# Autodesk Inventor assembly: 22.10.2025 - calosc
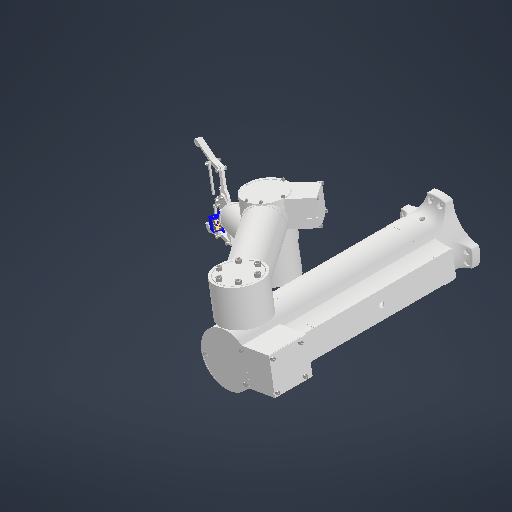
[picture p0: Inventor's stored thumbnail of the model, 512x512]
Saved by Autodesk Inventor 2026.1 (Build 301233020, 233B)
## iProperties
Created: 2026-01-25
Part Number: 22.10.2025 - calosc
Document SubType Name: Assembly
Designer: Nitro
Author: Nitro
## Documents named in this file (63)
- C:\Users\Nitro\Pictures\Bryły\22.10.2025 - calosc.iam
- C:\Users\Nitro\Pictures\Bryły\22.10.2025-01.ipt
- C:\Users\Nitro\Pictures\Bryły\22.10.2025 - calosc\Design Accelerator\Łożysko1.iam
- C:\Users\Nitro\Pictures\Bryły\22.10.2025 - calosc\Design Accelerator\Łożysko2.iam
- C:\Users\Nitro\Pictures\Bryły\22.10.2025 - calosc\Design Accelerator\Łożysko3.iam
- C:\Users\Nitro\Pictures\Bryły\22.10.2025 - calosc\Design Accelerator\Łożysko4.iam
- C:\Users\Nitro\Pictures\Bryły\22.10.2025 - calosc\Design Accelerator\Łożysko5.iam
- C:\Users\Nitro\Pictures\Bryły\22.10.2025 - calosc\Design Accelerator\Łożysko6.iam
- C:\Users\Nitro\Pictures\Bryły\22.10.2025-p2.ipt
- C:\Users\Nitro\Documents\Inventor\Content Center Files\R2026\pl-PL\CNS 3932\CNS 3932 - M 3 x 0,5 x 10.ipt
- C:\Users\Nitro\Pictures\Bryły\22.10.2025-04.ipt
- C:\Users\Nitro\Documents\Inventor\Content Center Files\R2026\pl-PL\CNS 3932\CNS 3932 - M 5 x 0,8 x 10.ipt
- C:\Users\Nitro\Documents\Inventor\Content Center Files\R2026\pl-PL\CNS 3932\CNS 3932 - M 6 x 1 x 22.ipt
- C:\Users\Nitro\Pictures\Bryły\22.10.2025-05.ipt
- C:\Users\Nitro\Documents\Inventor\Content Center Files\R2026\pl-PL\CNS 3932\CNS 3932 - M 6 x 1 x 25.ipt
- C:\Users\Nitro\Pictures\Bryły\22.10.2025-07.ipt
- C:\Users\Nitro\Documents\Inventor\Content Center Files\R2026\pl-PL\CNS 3932\CNS 3932 - M 6 x 1 x 10.ipt
- C:\Users\Nitro\Documents\Inventor\Content Center Files\R2026\pl-PL\CNS 3932\CNS 3932 - M 10 x 1,5 x 20.ipt
- C:\Users\Nitro\Pictures\Bryły\22.10.2025-12.ipt
- C:\Users\Nitro\Pictures\Bryły\22.10.2025-10.ipt
- C:\Users\Nitro\Pictures\Bryły\22.10.2025-11.ipt
- C:\Users\Nitro\Documents\Inventor\Content Center Files\R2026\pl-PL\CNS 3932\CNS 3932 - M 4 x 0,7 x 16.ipt
- C:\Users\Nitro\Pictures\Bryły\22.10.2025-p3 -p3.ipt
- C:\Users\Nitro\Pictures\Bryły\22.10.2025-p4.ipt
- C:\Users\Nitro\Pictures\Bryły\22.10.2025-s1.ipt
- C:\Users\Nitro\Pictures\Bryły\22.10.2025-08.ipt
- C:\Users\Nitro\Documents\Inventor\Content Center Files\R2026\pl-PL\CNS 3932\CNS 3932 - M 3 x 0,5 x 5.ipt
- C:\Users\Nitro\Documents\Inventor\Content Center Files\R2026\pl-PL\CNS 3932\CNS 3932 - M 4 x 0,7 x 10.ipt
- C:\Users\Nitro\Documents\Inventor\Content Center Files\R2026\pl-PL\GB 833-88\Screw GB 833 M3 x 10.ipt
- C:\Users\Nitro\Pictures\Bryły\22.10.2025-09.ipt
- C:\Users\Nitro\Documents\Inventor\Content Center Files\R2026\pl-PL\DIN 7985 (H)\DIN 7985 (H) - M3x5-H.ipt
- C:\Users\Nitro\Pictures\Bryły\22.10.2025-p1.ipt
- C:\Users\Nitro\Pictures\Bryły\22.10.2025-13.ipt
- C:\Users\Nitro\Documents\Inventor\Content Center Files\R2026\pl-PL\CNS 3932\CNS 3932 - M 8 x 1,25 x 20.ipt
- C:\Users\Nitro\Pictures\Bryły\22.10.2-25-26.ipt
- C:\Users\Nitro\Pictures\Bryły\22.10.2025-16.ipt
- C:\Users\Nitro\Pictures\Bryły\22.10.2025-25.ipt
- C:\Users\Nitro\Pictures\Bryły\22.10.2025 - calosc\Design Accelerator\Łożysko7.iam
- C:\Users\Nitro\Pictures\Bryły\22.10.2025 - calosc\Design Accelerator\Łożysko8.iam
- C:\Users\Nitro\Pictures\Bryły\22.10.2025 - calosc\Design Accelerator\Łożysko9.iam
- C:\Users\Nitro\Pictures\Bryły\22.10.2025 - calosc\Design Accelerator\Łożysko10.iam
- C:\Users\Nitro\Documents\Inventor\Content Center Files\R2026\pl-PL\CNS 3932\CNS 3932 - M 5 x 0,8 x 16.ipt
- C:\Users\Nitro\Documents\Inventor\Content Center Files\R2026\pl-PL\CNS 4355\CNS 4355 - M 3 x 30.ipt
- C:\Users\Nitro\Pictures\Bryły\22.10.2025-p6.ipt
- C:\Users\Nitro\Documents\Inventor\Content Center Files\R2026\pl-PL\CSN 02 1131  B\CSN 02 1131 - M3 x 10B.ipt
- C:\Users\Nitro\Pictures\Bryły\22.10.2025-p5.ipt
- C:\Users\Nitro\Documents\Inventor\Content Center Files\R2026\pl-PL\CSN 02 1131  B\CSN 02 1131 - M3 x 12B.ipt
- C:\Users\Nitro\Pictures\Bryły\22.10.2025-15.ipt
- C:\Users\Nitro\Pictures\Bryły\22.10.2025-14.ipt
- C:\Users\Nitro\Pictures\Bryły\22.10.2025-17.ipt
- C:\Users\Nitro\Pictures\Bryły\22.10.2025-21.ipt
- C:\Users\Nitro\Documents\Inventor\Content Center Files\R2026\pl-PL\CNS 4355\CNS 4355 - M 4 x 14.ipt
- C:\Users\Nitro\Documents\Inventor\Content Center Files\R2026\pl-PL\CNS 4355\CNS 4355 - M 4 x 10.ipt
- C:\Users\Nitro\Pictures\Bryły\22.10.2025-18.ipt
- C:\Users\Nitro\Pictures\Bryły\Część2_MIR_MIR.ipt
- C:\Users\Nitro\Pictures\Bryły\22.10.2025-20.ipt
- C:\Users\Nitro\Pictures\Bryły\22.10.2025-22.ipt
- C:\Users\Nitro\Pictures\Bryły\22.10.2025-19_MIR2_MIR.ipt
- C:\Users\Nitro\Pictures\Bryły\22.10.2025-20_MIR1.ipt
- C:\Users\Nitro\Documents\Inventor\Content Center Files\R2026\pl-PL\CNS 3932\CNS 3932 - M 4 x 0,7 x 14.ipt
- C:\Users\Nitro\Documents\Inventor\Content Center Files\R2026\pl-PL\CNS 3932\CNS 3932 - M 4 x 0,7 x 12.ipt
- C:\Users\Nitro\Documents\Inventor\Content Center Files\R2026\pl-PL\CNS 3932\CNS 3932 - M 4 x 0,7 x 20.ipt
- C:\Users\Nitro\Documents\Inventor\Content Center Files\R2026\pl-PL\ANSI B18.2.4.2M\ANSI B18.2.4.2M - M3,5x0,6 - 6.ipt
## Components (130 placed, 49 different names)
1. 22.10.2025-01:1 — Wstawiające:1, Wstawiające:2, Zestawiające:1, Wstawiające:4, Wstawiające:5
2. Łożysko:1 [sub-assembly] — Wstawiające:1
3. Łożysko:2 [sub-assembly] — Wstawiające:2, Wstawiające:3
4. Przekładnia walcowa1:1 — Zestawiające:1, Obrotowe:1, Obrotowe:2, Obrotowe:3, Obrotowe:4
5. CNS 3932 M 3 x 10:2 — Obrotowe:1
6. CNS 3932 M 3 x 10:3 — Obrotowe:4
7. CNS 3932 M 3 x 10:4 — Obrotowe:3
8. CNS 3932 M 3 x 10:5 — Obrotowe:2
9. 22.10.2025-04:1 — Wstawiające:3, Sztywne:1, Sztywne:7, Zestawiające:51, Zestawiające:53
10. CNS 3932 M 6 x 22:1 — Wstawiające:4
11. CNS 3932 M 6 x 22:2 — Wstawiające:5
12. 22.10.2025-05:1 — Sztywne:1, Zestawiające:2, Zestawiające:3, Zestawiające:4, Zestawiające:5, Zestawiające:6, Zestawiające:7, Sztywne:2
13. CNS 3932 M 6 x 25:1 — Zestawiające:2, Zestawiające:3
14. CNS 3932 M 6 x 25:2 — Zestawiające:4, Zestawiające:5
15. CNS 3932 M 6 x 25:3 — Zestawiające:6, Zestawiające:7
16. 22.10.2025-07:1 — Sztywne:2, Zestawiające:8, Zestawiające:9, Zestawiające:10, Zestawiające:11, Zestawiające:12, Zestawiające:13, Wstawiające:6, Obrotowe:5, Wstawiające:8, Wstawiające:9, Sztywne:4, Zestawiające:32, Zestawiające:34, Zestawiające:37, Zestawiające:39, Zestawiające:41, Zestawiające:43, Sztywne:6, Zestawiające:44, Zestawiające:46, Zestawiające:48
17. CNS 3932 M 10 x 20:1 — Zestawiające:8, Zestawiające:9
18. CNS 3932 M 10 x 20:2 — Zestawiające:10, Zestawiające:11
19. CNS 3932 M 10 x 20:3 — Zestawiające:12, Zestawiające:13
20. Łożysko:3 [sub-assembly] — Wstawiające:7
21. Łożysko:4 [sub-assembly] — Obrotowe:6, Wstawiające:8
22. Łożysko:5 [sub-assembly] — Obrotowe:5
23. Łożysko:6 [sub-assembly] — Wstawiające:6
24. 22.10.2025-12:1 — Obrotowe:6, Wstawiające:7, Sztywne:8
25. 22.10.2025-10:1 — Wstawiające:9, Wstawiające:10, Wstawiające:11, Wstawiające:12, Wstawiające:13, Wstawiające:14, Wstawiające:15, Wstawiające:16
26. CNS 3932 M 6 x 10:1 — Wstawiające:10
27. CNS 3932 M 6 x 10:2 — Wstawiające:11
28. CNS 3932 M 6 x 10:3 — Wstawiające:12
29. CNS 3932 M 6 x 10:4 — Wstawiające:13
30. CNS 3932 M 6 x 10:5 — Wstawiające:14
31. CNS 3932 M 6 x 10:6 — Wstawiające:15
32. 22.10.2025-11:1 — Wstawiające:16, Zestawiające:14, Zestawiające:15, Zestawiające:16, Zestawiające:17, Zestawiające:18, Sztywne:3
33. CNS 3932 M 4 x 16:2 — Zestawiające:14, Zestawiające:15
34. CNS 3932 M 4 x 16:1 — Zestawiające:16, Zestawiające:17
35. Przekładnia stożkowa1:1 — Zestawiające:18, Sztywne:3, Zestawiające:19, Zestawiające:20, Zestawiające:21, Zestawiające:22, Zestawiające:23, Zestawiające:24, Zestawiające:25, Zestawiające:26
36. CNS 3932 M 5 x 10:1 — Zestawiające:19, Zestawiające:20
37. CNS 3932 M 5 x 10:2 — Zestawiające:21, Zestawiające:22
38. CNS 3932 M 5 x 10:3 — Zestawiające:23, Zestawiające:24
39. CNS 3932 M 5 x 10:4 — Zestawiające:25, Zestawiające:26
40. Przekładnia stożkowa2:1 — Obrotowe:7
41. 22.10.2025-s1:1 — Sztywne:5, Zestawiające:36, Zestawiające:38, Zestawiające:40, Zestawiające:42, Obrotowe:7
42. 22.10.2025-08:1 — Sztywne:4, Zestawiające:28, Zestawiające:29, Zestawiające:30, Zestawiające:31, Zestawiające:33, Zestawiające:35, Sztywne:5
43. CNS 3932 M 4 x 10:1 — Zestawiające:28, Zestawiające:29
44. CNS 3932 M 4 x 10:2 — Zestawiające:30, Zestawiające:31
45. CNS 3932 M 4 x 10:3 — Zestawiające:32, Zestawiające:33
46. CNS 3932 M 4 x 10:4 — Zestawiające:34, Zestawiające:35
47. Screw GB/T 833-1988 M3 x 10:2 — Zestawiające:36, Zestawiające:37
48. Screw GB/T 833-1988 M3 x 10:1 — Zestawiające:38, Zestawiające:39
49. Screw GB/T 833-1988 M3 x 10:3 — Zestawiające:40, Zestawiające:41
50. Screw GB/T 833-1988 M3 x 10:4 — Zestawiające:42, Zestawiające:43
51. 22.10.2025-09:1 — Sztywne:6, Zestawiające:45, Zestawiające:47, Zestawiające:49
52. CNS 3932 M 4 x 10:5 — Zestawiające:44, Zestawiające:45
53. CNS 3932 M 4 x 10:6 — Zestawiające:46, Zestawiające:47
54. CNS 3932 M 4 x 10:7 — Zestawiające:48, Zestawiające:49
55. 22.10.2025-s1:2 — Sztywne:7, Zestawiające:50, Zestawiające:52, Obrotowe:8
56. DIN 7985 (H) M3x5-H:1 — Zestawiające:50, Zestawiające:51
57. DIN 7985 (H) M3x5-H:2 — Zestawiające:52, Zestawiające:53
58. Przekładnia walcowa1:2 — Obrotowe:8
59. 22.10.2025-13:1 — Sztywne:8, Zestawiające:54, Zestawiające:55, Zestawiające:56, Zestawiające:57, Zestawiające:58, Zestawiające:59, Zestawiające:60, Zestawiające:61, Wstawiające:19, Wstawiające:20, Wstawiające:21, Sztywne:9, Zestawiające:83, Zestawiające:85, Zestawiające:87, Zestawiające:89, Równoległe:1, Zestawiające:90, Zestawiające:95, Zestawiające:99
60. CNS 3932 M 8 x 20:1 — Zestawiające:54, Zestawiające:55
61. CNS 3932 M 8 x 20:2 — Zestawiające:56, Zestawiające:57
62. CNS 3932 M 8 x 20:3 — Zestawiające:58, Zestawiające:59
63. CNS 3932 M 8 x 20:4 — Zestawiające:60, Zestawiające:61
64. 22.10.2-25-26:1 — Wstawiające:22, Zestawiające:62, Zestawiające:63, Zestawiające:64, Zestawiające:65, Zestawiające:66, Zestawiające:67, Zestawiające:68, Zestawiające:69, Wstawiające:23
65. 22.10.2025-16:1 — Wstawiające:17, Wstawiające:18, Wstawiające:22, Sztywne:11
66. 22.10.2025-25:1 — Wstawiające:23, Zestawiające:70, Zestawiające:71, Zestawiające:72, Zestawiające:73, Obrotowe:9
67. Łożysko:7 [sub-assembly] — Wstawiające:18, Wstawiające:21
68. Łożysko:8 [sub-assembly] — Wstawiające:17
69. Łożysko:9 [sub-assembly] — Wstawiające:20
70. Łożysko:10 [sub-assembly] — Wstawiające:19
71. CNS 3932 M 5 x 16:1 — Zestawiające:62, Zestawiające:63
72. CNS 3932 M 5 x 16:2 — Zestawiające:64, Zestawiające:65
73. CNS 3932 M 5 x 16:3 — Zestawiające:66, Zestawiające:67
74. CNS 3932 M 5 x 16:4 — Zestawiające:68, Zestawiające:69
75. CNS 4355 M 3 x 30:1 — Zestawiające:70, Zestawiające:71
76. CNS 4355 M 3 x 30:2 — Zestawiające:72, Zestawiające:73
77. Przekładnia stożkowa1:2 — Obrotowe:9, Zestawiające:74, Zestawiające:75, Zestawiające:76, Zestawiające:77, Zestawiające:78, Zestawiające:79, Zestawiające:80, Zestawiające:81
78. CSN 02 1131 B M3 x 10:1 — Zestawiające:74, Zestawiające:75
79. CSN 02 1131 B M3 x 10:2 — Zestawiające:76, Zestawiające:77
80. CSN 02 1131 B M3 x 10:3 — Zestawiające:78, Zestawiające:79
81. CSN 02 1131 B M3 x 10:4 — Zestawiające:80, Zestawiające:81
82. 22.10.2025-s1:3 — Sztywne:9, Obrotowe:10, Zestawiające:82, Zestawiające:84, Zestawiające:86, Zestawiające:88, Sztywne:10
83. Przekładnia stożkowa2:2 — Obrotowe:10
84. CSN 02 1131 B M3 x 12:1 — Zestawiające:82, Zestawiające:83
85. CSN 02 1131 B M3 x 12:2 — Zestawiające:84, Zestawiające:85
86. CSN 02 1131 B M3 x 12:3 — Zestawiające:86, Zestawiające:87
87. CSN 02 1131 B M3 x 12:4 — Zestawiające:88, Zestawiające:89
88. 22.10.2025-15:1 — Równoległe:1, Zestawiające:90, Zestawiające:91, Zestawiające:92, Zestawiające:93, Zestawiające:94, Zestawiające:96, Zestawiające:97, Zestawiające:98
89. CNS 3932 M 3 x 5:1 — Zestawiające:91, Zestawiające:92
90. CNS 3932 M 3 x 5:2 — Zestawiające:93, Zestawiające:94
91. CNS 3932 M 3 x 5:3 — Zestawiające:95, Zestawiające:96
92. CNS 3932 M 3 x 5:4 — Zestawiające:97, Zestawiające:98
93. 22.10.2025-14:1 — Sztywne:10, Zestawiające:100, Zestawiające:101, Zestawiające:102, Zestawiające:103, Zestawiające:104, Zestawiające:105, Zestawiające:106
94. CNS 3932 M 3 x 5:5 — Zestawiające:99, Zestawiające:100
95. CNS 3932 M 3 x 5:6 — Zestawiające:101, Zestawiające:102
96. CNS 3932 M 3 x 5:7 — Zestawiające:103, Zestawiające:104
97. CNS 3932 M 3 x 5:8 — Zestawiające:105, Zestawiające:106
98. 22.10.2025-21:1 — Sztywne:12, Zestawiające:107, Zestawiające:108, Zestawiające:109, Zestawiające:110, Zestawiające:111, Zestawiające:112, Sztywne:13, Sztywne:14, Wstawiające:28, Wstawiające:29, Wstawiające:30, Wstawiające:42, Wstawiające:43, Wstawiające:44, Wstawiające:45
99. 22.10.2025-17:1 — Sztywne:11, Wstawiające:24, Wstawiające:25, Wstawiające:26, Wstawiające:27, Sztywne:12
100. CNS 4355 M 4 x 14:1 — Wstawiające:24
101. CNS 4355 M 4 x 14:2 — Wstawiające:25
102. CNS 4355 M 4 x 14:3 — Wstawiające:26
103. CNS 4355 M 4 x 14:4 — Wstawiające:27
104. CNS 4355 M 4 x 10:1 — Zestawiające:107, Zestawiające:108
105. CNS 4355 M 4 x 10:2 — Zestawiające:109, Zestawiające:110
106. CNS 4355 M 4 x 10:3 — Zestawiające:111, Zestawiające:112
107. Część2_MIR_MIR:1 — Sztywne:13, Sztywne:15
108. Przekładnia walcowa1:3 — Sztywne:14, Sztywne:17, Wstawiające:40, Wstawiające:41
109. 22.10.2025-19_MIR2_MIR:1 — Sztywne:15, Sztywne:16
110. 22.10.2025-20_MIR1:1 — Sztywne:16, Sztywne:18, Wstawiające:34, Wstawiające:38, Wstawiające:39
111. 22.10.2025-20:1 — Sztywne:17, Wstawiające:31, Wstawiające:36, Wstawiające:37, Sztywne:19
112. 22.10.2025-22:2 — Sztywne:18, Wstawiające:35
113. CNS 3932 M 4 x 12:1 — Wstawiające:28
114. CNS 3932 M 4 x 12:3 — Wstawiające:29
115. CNS 3932 M 4 x 12:2 — Wstawiające:30
116. CNS 3932 M 4 x 14:1 — Wstawiające:31
117. CNS 3932 M 4 x 14:2 — Wstawiające:34
118. CNS 3932 M 4 x 20:2 — Wstawiające:35
119. ANSI B18.2.4.2M M3,5x0,6:1 — Wstawiające:36
120. ANSI B18.2.4.2M M3,5x0,6:2 — Wstawiające:37
121. ANSI B18.2.4.2M M3,5x0,6:3 — Wstawiające:38
122. ANSI B18.2.4.2M M3,5x0,6:4 — Wstawiające:39
123. ANSI B18.2.4.2M M3,5x0,6:5 — Wstawiające:40
124. ANSI B18.2.4.2M M3,5x0,6:6 — Wstawiające:41
125. ANSI B18.2.4.2M M3,5x0,6:7 — Wstawiające:42
126. ANSI B18.2.4.2M M3,5x0,6:8 — Wstawiające:43
127. ANSI B18.2.4.2M M3,5x0,6:9 — Wstawiające:44
128. ANSI B18.2.4.2M M3,5x0,6:10 — Wstawiające:45
129. 22.10.2025-22:3 — Sztywne:19, Wstawiające:46
130. CNS 3932 M 4 x 20:3 — Wstawiające:46
## Relationships (185: Mate 111, Insert 44, WeldJoint 19, RevoluteJoint 10, Flush 1)
- Wstawiające:1 [Insert]: 22.10.2025-01:1 ↔ Łożysko:1
- Wstawiające:2 [Insert]: 22.10.2025-01:1 ↔ Łożysko:2
- Zestawiające:1 [Mate]: 22.10.2025-01:1 ↔ Przekładnia walcowa1:1
- Obrotowe:1 [RevoluteJoint]: Przekładnia walcowa1:1 ↔ CNS 3932 M 3 x 10:2
- Obrotowe:2 [RevoluteJoint]: Przekładnia walcowa1:1 ↔ CNS 3932 M 3 x 10:5
- Obrotowe:3 [RevoluteJoint]: Przekładnia walcowa1:1 ↔ CNS 3932 M 3 x 10:4
- Obrotowe:4 [RevoluteJoint]: Przekładnia walcowa1:1 ↔ CNS 3932 M 3 x 10:3
- Wstawiające:3 [Insert]: Łożysko:2 ↔ 22.10.2025-04:1
- Wstawiające:4 [Insert]: 22.10.2025-01:1 ↔ CNS 3932 M 6 x 22:1
- Wstawiające:5 [Insert]: 22.10.2025-01:1 ↔ CNS 3932 M 6 x 22:2
- Sztywne:1 [WeldJoint]: 22.10.2025-04:1 ↔ 22.10.2025-05:1
- Zestawiające:2 [Mate]: 22.10.2025-05:1 ↔ CNS 3932 M 6 x 25:1
- Zestawiające:3 [Mate]: 22.10.2025-05:1 ↔ CNS 3932 M 6 x 25:1
- Zestawiające:4 [Mate]: 22.10.2025-05:1 ↔ CNS 3932 M 6 x 25:2
- Zestawiające:5 [Mate]: 22.10.2025-05:1 ↔ CNS 3932 M 6 x 25:2
- Zestawiające:6 [Mate]: 22.10.2025-05:1 ↔ CNS 3932 M 6 x 25:3
- Zestawiające:7 [Mate]: 22.10.2025-05:1 ↔ CNS 3932 M 6 x 25:3
- Sztywne:2 [WeldJoint]: 22.10.2025-05:1 ↔ 22.10.2025-07:1
- Zestawiające:8 [Mate]: 22.10.2025-07:1 ↔ CNS 3932 M 10 x 20:1
- Zestawiające:9 [Mate]: 22.10.2025-07:1 ↔ CNS 3932 M 10 x 20:1
- Zestawiające:10 [Mate]: 22.10.2025-07:1 ↔ CNS 3932 M 10 x 20:2
- Zestawiające:11 [Mate]: 22.10.2025-07:1 ↔ CNS 3932 M 10 x 20:2
- Zestawiające:12 [Mate]: 22.10.2025-07:1 ↔ CNS 3932 M 10 x 20:3
- Zestawiające:13 [Mate]: 22.10.2025-07:1 ↔ CNS 3932 M 10 x 20:3
- Wstawiające:6 [Insert]: 22.10.2025-07:1 ↔ Łożysko:6
- Obrotowe:5 [RevoluteJoint]: 22.10.2025-07:1 ↔ Łożysko:5
- Obrotowe:6 [RevoluteJoint]: Łożysko:4 ↔ 22.10.2025-12:1
- Wstawiające:7 [Insert]: Łożysko:3 ↔ 22.10.2025-12:1
- Wstawiające:8 [Insert]: 22.10.2025-07:1 ↔ Łożysko:4
- Wstawiające:9 [Insert]: 22.10.2025-07:1 ↔ 22.10.2025-10:1
- Wstawiające:10 [Insert]: 22.10.2025-10:1 ↔ CNS 3932 M 6 x 10:1
- Wstawiające:11 [Insert]: 22.10.2025-10:1 ↔ CNS 3932 M 6 x 10:2
- Wstawiające:12 [Insert]: 22.10.2025-10:1 ↔ CNS 3932 M 6 x 10:3
- Wstawiające:13 [Insert]: 22.10.2025-10:1 ↔ CNS 3932 M 6 x 10:4
- Wstawiające:14 [Insert]: 22.10.2025-10:1 ↔ CNS 3932 M 6 x 10:5
- Wstawiające:15 [Insert]: 22.10.2025-10:1 ↔ CNS 3932 M 6 x 10:6
- Wstawiające:16 [Insert]: 22.10.2025-10:1 ↔ 22.10.2025-11:1
- Zestawiające:14 [Mate]: 22.10.2025-11:1 ↔ CNS 3932 M 4 x 16:2
- Zestawiające:15 [Mate]: 22.10.2025-11:1 ↔ CNS 3932 M 4 x 16:2
- Zestawiające:16 [Mate]: 22.10.2025-11:1 ↔ CNS 3932 M 4 x 16:1
- Zestawiające:17 [Mate]: 22.10.2025-11:1 ↔ CNS 3932 M 4 x 16:1
- Zestawiające:18 [Mate]: 22.10.2025-11:1 ↔ Przekładnia stożkowa1:1
- Sztywne:3 [WeldJoint]: 22.10.2025-11:1 ↔ Przekładnia stożkowa1:1
- Zestawiające:19 [Mate]: Przekładnia stożkowa1:1 ↔ CNS 3932 M 5 x 10:1
- Zestawiające:20 [Mate]: Przekładnia stożkowa1:1 ↔ CNS 3932 M 5 x 10:1
- Zestawiające:21 [Mate]: Przekładnia stożkowa1:1 ↔ CNS 3932 M 5 x 10:2
- Zestawiające:22 [Mate]: Przekładnia stożkowa1:1 ↔ CNS 3932 M 5 x 10:2
- Zestawiające:23 [Mate]: Przekładnia stożkowa1:1 ↔ CNS 3932 M 5 x 10:3
- Zestawiające:24 [Mate]: Przekładnia stożkowa1:1 ↔ CNS 3932 M 5 x 10:3
- Zestawiające:25 [Mate]: Przekładnia stożkowa1:1 ↔ CNS 3932 M 5 x 10:4
- Zestawiające:26 [Mate]: Przekładnia stożkowa1:1 ↔ CNS 3932 M 5 x 10:4
- Sztywne:4 [WeldJoint] (-2 mm): 22.10.2025-07:1 ↔ 22.10.2025-08:1
- Zestawiające:28 [Mate]: 22.10.2025-08:1 ↔ CNS 3932 M 4 x 10:1
- Zestawiające:29 [Mate]: 22.10.2025-08:1 ↔ CNS 3932 M 4 x 10:1
- Zestawiające:30 [Mate]: 22.10.2025-08:1 ↔ CNS 3932 M 4 x 10:2
- Zestawiające:31 [Mate]: 22.10.2025-08:1 ↔ CNS 3932 M 4 x 10:2
- Zestawiające:32 [Mate]: 22.10.2025-07:1 ↔ CNS 3932 M 4 x 10:3
- Zestawiające:33 [Mate]: 22.10.2025-08:1 ↔ CNS 3932 M 4 x 10:3
- Zestawiające:34 [Mate]: 22.10.2025-07:1 ↔ CNS 3932 M 4 x 10:4
- Zestawiające:35 [Mate]: 22.10.2025-08:1 ↔ CNS 3932 M 4 x 10:4
- Sztywne:5 [WeldJoint] (10 mm): 22.10.2025-s1:1 ↔ 22.10.2025-08:1
- Zestawiające:36 [Mate]: 22.10.2025-s1:1 ↔ Screw GB/T 833-1988 M3 x 10:2
- Zestawiające:37 [Mate]: 22.10.2025-07:1 ↔ Screw GB/T 833-1988 M3 x 10:2
- Zestawiające:38 [Mate]: 22.10.2025-s1:1 ↔ Screw GB/T 833-1988 M3 x 10:1
- Zestawiające:39 [Mate]: 22.10.2025-07:1 ↔ Screw GB/T 833-1988 M3 x 10:1
- Zestawiające:40 [Mate]: 22.10.2025-s1:1 ↔ Screw GB/T 833-1988 M3 x 10:3
- Zestawiające:41 [Mate]: 22.10.2025-07:1 ↔ Screw GB/T 833-1988 M3 x 10:3
- Zestawiające:42 [Mate]: 22.10.2025-s1:1 ↔ Screw GB/T 833-1988 M3 x 10:4
- Zestawiające:43 [Mate]: 22.10.2025-07:1 ↔ Screw GB/T 833-1988 M3 x 10:4
- Obrotowe:7 [RevoluteJoint] (8 mm): Przekładnia stożkowa2:1 ↔ 22.10.2025-s1:1
- Sztywne:6 [WeldJoint]: 22.10.2025-07:1 ↔ 22.10.2025-09:1
- Zestawiające:44 [Mate]: 22.10.2025-07:1 ↔ CNS 3932 M 4 x 10:5
- Zestawiające:45 [Mate]: 22.10.2025-09:1 ↔ CNS 3932 M 4 x 10:5
- Zestawiające:46 [Mate]: 22.10.2025-07:1 ↔ CNS 3932 M 4 x 10:6
- Zestawiające:47 [Mate]: 22.10.2025-09:1 ↔ CNS 3932 M 4 x 10:6
- Zestawiające:48 [Mate]: 22.10.2025-07:1 ↔ CNS 3932 M 4 x 10:7
- Zestawiające:49 [Mate]: 22.10.2025-09:1 ↔ CNS 3932 M 4 x 10:7
- Sztywne:7 [WeldJoint] (-15 mm): 22.10.2025-04:1 ↔ 22.10.2025-s1:2
- Zestawiające:50 [Mate]: 22.10.2025-s1:2 ↔ DIN 7985 (H) M3x5-H:1
- Zestawiające:51 [Mate]: 22.10.2025-04:1 ↔ DIN 7985 (H) M3x5-H:1
- Zestawiające:52 [Mate]: 22.10.2025-s1:2 ↔ DIN 7985 (H) M3x5-H:2
- Zestawiające:53 [Mate]: 22.10.2025-04:1 ↔ DIN 7985 (H) M3x5-H:2
- Obrotowe:8 [RevoluteJoint]: 22.10.2025-s1:2 ↔ Przekładnia walcowa1:2
- Sztywne:8 [WeldJoint]: 22.10.2025-12:1 ↔ 22.10.2025-13:1
- Zestawiające:54 [Mate]: 22.10.2025-13:1 ↔ CNS 3932 M 8 x 20:1
- Zestawiające:55 [Mate]: 22.10.2025-13:1 ↔ CNS 3932 M 8 x 20:1
- Zestawiające:56 [Mate]: 22.10.2025-13:1 ↔ CNS 3932 M 8 x 20:2
- Zestawiające:57 [Mate]: 22.10.2025-13:1 ↔ CNS 3932 M 8 x 20:2
- Zestawiające:58 [Mate]: 22.10.2025-13:1 ↔ CNS 3932 M 8 x 20:3
- Zestawiające:59 [Mate]: 22.10.2025-13:1 ↔ CNS 3932 M 8 x 20:3
- Zestawiające:60 [Mate]: 22.10.2025-13:1 ↔ CNS 3932 M 8 x 20:4
- Zestawiające:61 [Mate]: 22.10.2025-13:1 ↔ CNS 3932 M 8 x 20:4
- Wstawiające:17 [Insert]: 22.10.2025-16:1 ↔ Łożysko:8
- Wstawiające:18 [Insert]: 22.10.2025-16:1 ↔ Łożysko:7
- Wstawiające:19 [Insert]: 22.10.2025-13:1 ↔ Łożysko:10
- Wstawiające:20 [Insert]: 22.10.2025-13:1 ↔ Łożysko:9
- Wstawiające:21 [Insert]: 22.10.2025-13:1 ↔ Łożysko:7
- Wstawiające:22 [Insert]: 22.10.2-25-26:1 ↔ 22.10.2025-16:1
- Zestawiające:62 [Mate]: 22.10.2-25-26:1 ↔ CNS 3932 M 5 x 16:1
- Zestawiające:63 [Mate]: 22.10.2-25-26:1 ↔ CNS 3932 M 5 x 16:1
- Zestawiające:64 [Mate]: 22.10.2-25-26:1 ↔ CNS 3932 M 5 x 16:2
- Zestawiające:65 [Mate]: 22.10.2-25-26:1 ↔ CNS 3932 M 5 x 16:2
- Zestawiające:66 [Mate]: 22.10.2-25-26:1 ↔ CNS 3932 M 5 x 16:3
- Zestawiające:67 [Mate]: 22.10.2-25-26:1 ↔ CNS 3932 M 5 x 16:3
- Zestawiające:68 [Mate]: 22.10.2-25-26:1 ↔ CNS 3932 M 5 x 16:4
- Zestawiające:69 [Mate]: 22.10.2-25-26:1 ↔ CNS 3932 M 5 x 16:4
- Wstawiające:23 [Insert]: 22.10.2-25-26:1 ↔ 22.10.2025-25:1
- Zestawiające:70 [Mate]: 22.10.2025-25:1 ↔ CNS 4355 M 3 x 30:1
- Zestawiające:71 [Mate]: 22.10.2025-25:1 ↔ CNS 4355 M 3 x 30:1
- Zestawiające:72 [Mate]: 22.10.2025-25:1 ↔ CNS 4355 M 3 x 30:2
- Zestawiające:73 [Mate]: 22.10.2025-25:1 ↔ CNS 4355 M 3 x 30:2
- Obrotowe:9 [RevoluteJoint]: 22.10.2025-25:1 ↔ Przekładnia stożkowa1:2
- Zestawiające:74 [Mate]: Przekładnia stożkowa1:2 ↔ CSN 02 1131 B M3 x 10:1
- Zestawiające:75 [Mate]: Przekładnia stożkowa1:2 ↔ CSN 02 1131 B M3 x 10:1
- Zestawiające:76 [Mate]: Przekładnia stożkowa1:2 ↔ CSN 02 1131 B M3 x 10:2
- Zestawiające:77 [Mate]: Przekładnia stożkowa1:2 ↔ CSN 02 1131 B M3 x 10:2
- Zestawiające:78 [Mate]: Przekładnia stożkowa1:2 ↔ CSN 02 1131 B M3 x 10:3
- Zestawiające:79 [Mate]: Przekładnia stożkowa1:2 ↔ CSN 02 1131 B M3 x 10:3
- Zestawiające:80 [Mate]: Przekładnia stożkowa1:2 ↔ CSN 02 1131 B M3 x 10:4
- Zestawiające:81 [Mate]: Przekładnia stożkowa1:2 ↔ CSN 02 1131 B M3 x 10:4
- Sztywne:9 [WeldJoint]: 22.10.2025-13:1 ↔ 22.10.2025-s1:3
- Obrotowe:10 [RevoluteJoint]: 22.10.2025-s1:3 ↔ Przekładnia stożkowa2:2
- Zestawiające:82 [Mate]: 22.10.2025-s1:3 ↔ CSN 02 1131 B M3 x 12:1
- Zestawiające:83 [Mate]: 22.10.2025-13:1 ↔ CSN 02 1131 B M3 x 12:1
- Zestawiające:84 [Mate]: 22.10.2025-s1:3 ↔ CSN 02 1131 B M3 x 12:2
- Zestawiające:85 [Mate]: 22.10.2025-13:1 ↔ CSN 02 1131 B M3 x 12:2
- Zestawiające:86 [Mate]: 22.10.2025-s1:3 ↔ CSN 02 1131 B M3 x 12:3
- Zestawiające:87 [Mate]: 22.10.2025-13:1 ↔ CSN 02 1131 B M3 x 12:3
- Zestawiające:88 [Mate]: 22.10.2025-s1:3 ↔ CSN 02 1131 B M3 x 12:4
- Zestawiające:89 [Mate]: 22.10.2025-13:1 ↔ CSN 02 1131 B M3 x 12:4
- Równoległe:1 [Flush]: 22.10.2025-13:1 ↔ 22.10.2025-15:1
- Zestawiające:90 [Mate]: 22.10.2025-13:1 ↔ 22.10.2025-15:1
- Zestawiające:91 [Mate]: 22.10.2025-15:1 ↔ CNS 3932 M 3 x 5:1
- Zestawiające:92 [Mate]: 22.10.2025-15:1 ↔ CNS 3932 M 3 x 5:1
- Zestawiające:93 [Mate]: 22.10.2025-15:1 ↔ CNS 3932 M 3 x 5:2
- Zestawiające:94 [Mate]: 22.10.2025-15:1 ↔ CNS 3932 M 3 x 5:2
- Zestawiające:95 [Mate]: 22.10.2025-13:1 ↔ CNS 3932 M 3 x 5:3
- Zestawiające:96 [Mate]: 22.10.2025-15:1 ↔ CNS 3932 M 3 x 5:3
- Zestawiające:97 [Mate]: 22.10.2025-15:1 ↔ CNS 3932 M 3 x 5:4
- Zestawiające:98 [Mate]: 22.10.2025-15:1 ↔ CNS 3932 M 3 x 5:4
- Sztywne:10 [WeldJoint] (3 mm): 22.10.2025-s1:3 ↔ 22.10.2025-14:1
- Zestawiające:99 [Mate]: 22.10.2025-13:1 ↔ CNS 3932 M 3 x 5:5
- Zestawiające:100 [Mate]: 22.10.2025-14:1 ↔ CNS 3932 M 3 x 5:5
- Zestawiające:101 [Mate]: 22.10.2025-14:1 ↔ CNS 3932 M 3 x 5:6
- Zestawiające:102 [Mate]: 22.10.2025-14:1 ↔ CNS 3932 M 3 x 5:6
- Zestawiające:103 [Mate]: 22.10.2025-14:1 ↔ CNS 3932 M 3 x 5:7
- Zestawiające:104 [Mate]: 22.10.2025-14:1 ↔ CNS 3932 M 3 x 5:7
- Zestawiające:105 [Mate]: 22.10.2025-14:1 ↔ CNS 3932 M 3 x 5:8
- Zestawiające:106 [Mate]: 22.10.2025-14:1 ↔ CNS 3932 M 3 x 5:8
- Sztywne:11 [WeldJoint]: 22.10.2025-16:1 ↔ 22.10.2025-17:1
- Wstawiające:24 [Insert]: 22.10.2025-17:1 ↔ CNS 4355 M 4 x 14:1
- Wstawiające:25 [Insert]: 22.10.2025-17:1 ↔ CNS 4355 M 4 x 14:2
- Wstawiające:26 [Insert]: 22.10.2025-17:1 ↔ CNS 4355 M 4 x 14:3
- Wstawiające:27 [Insert]: 22.10.2025-17:1 ↔ CNS 4355 M 4 x 14:4
- Sztywne:12 [WeldJoint]: 22.10.2025-21:1 ↔ 22.10.2025-17:1
- Zestawiające:107 [Mate]: 22.10.2025-21:1 ↔ CNS 4355 M 4 x 10:1
- Zestawiające:108 [Mate]: 22.10.2025-21:1 ↔ CNS 4355 M 4 x 10:1
- Zestawiające:109 [Mate]: 22.10.2025-21:1 ↔ CNS 4355 M 4 x 10:2
- Zestawiające:110 [Mate]: 22.10.2025-21:1 ↔ CNS 4355 M 4 x 10:2
- Zestawiające:111 [Mate]: 22.10.2025-21:1 ↔ CNS 4355 M 4 x 10:3
- Zestawiające:112 [Mate]: 22.10.2025-21:1 ↔ CNS 4355 M 4 x 10:3
- Sztywne:13 [WeldJoint] (7 mm): 22.10.2025-21:1 ↔ Część2_MIR_MIR:1
- Sztywne:14 [WeldJoint]: 22.10.2025-21:1 ↔ Przekładnia walcowa1:3
- Sztywne:15 [WeldJoint]: Część2_MIR_MIR:1 ↔ 22.10.2025-19_MIR2_MIR:1
- Sztywne:16 [WeldJoint]: 22.10.2025-19_MIR2_MIR:1 ↔ 22.10.2025-20_MIR1:1
- Sztywne:17 [WeldJoint]: Przekładnia walcowa1:3 ↔ 22.10.2025-20:1
- Sztywne:18 [WeldJoint]: 22.10.2025-20_MIR1:1 ↔ 22.10.2025-22:2
- Wstawiające:28 [Insert]: 22.10.2025-21:1 ↔ CNS 3932 M 4 x 12:1
- Wstawiające:29 [Insert]: 22.10.2025-21:1 ↔ CNS 3932 M 4 x 12:3
- Wstawiające:30 [Insert]: 22.10.2025-21:1 ↔ CNS 3932 M 4 x 12:2
- Wstawiające:31 [Insert]: 22.10.2025-20:1 ↔ CNS 3932 M 4 x 14:1
- Wstawiające:34 [Insert]: 22.10.2025-20_MIR1:1 ↔ CNS 3932 M 4 x 14:2
- Wstawiające:35 [Insert]: 22.10.2025-22:2 ↔ CNS 3932 M 4 x 20:2
- Wstawiające:36 [Insert]: 22.10.2025-20:1 ↔ ANSI B18.2.4.2M M3,5x0,6:1
- Wstawiające:37 [Insert]: 22.10.2025-20:1 ↔ ANSI B18.2.4.2M M3,5x0,6:2
- Wstawiające:38 [Insert]: 22.10.2025-20_MIR1:1 ↔ ANSI B18.2.4.2M M3,5x0,6:3
- Wstawiające:39 [Insert]: 22.10.2025-20_MIR1:1 ↔ ANSI B18.2.4.2M M3,5x0,6:4
- Wstawiające:40 [Insert]: Przekładnia walcowa1:3 ↔ ANSI B18.2.4.2M M3,5x0,6:5
- Wstawiające:41 [Insert]: Przekładnia walcowa1:3 ↔ ANSI B18.2.4.2M M3,5x0,6:6
- Wstawiające:42 [Insert]: 22.10.2025-21:1 ↔ ANSI B18.2.4.2M M3,5x0,6:7
- Wstawiające:43 [Insert]: 22.10.2025-21:1 ↔ ANSI B18.2.4.2M M3,5x0,6:8
- Wstawiające:44 [Insert]: 22.10.2025-21:1 ↔ ANSI B18.2.4.2M M3,5x0,6:9
- Wstawiające:45 [Insert]: 22.10.2025-21:1 ↔ ANSI B18.2.4.2M M3,5x0,6:10
- Sztywne:19 [WeldJoint]: 22.10.2025-20:1 ↔ 22.10.2025-22:3
- Wstawiające:46 [Insert]: 22.10.2025-22:3 ↔ CNS 3932 M 4 x 20:3
